# Autodesk Inventor assembly: Assembly
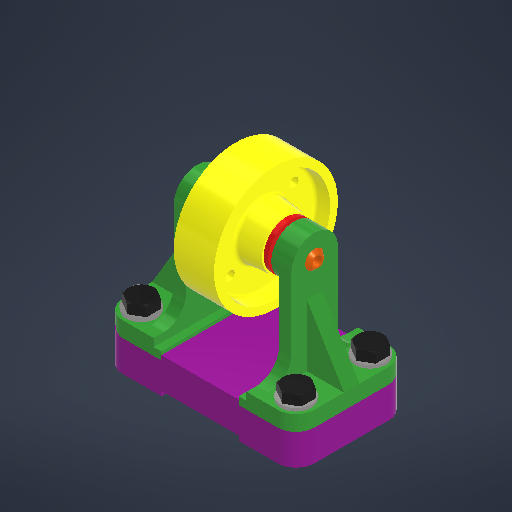
[picture p0: Inventor's stored thumbnail of the model, 512x512]
Saved by Autodesk Inventor 2026.3 (Build 303398000, 398)
## iProperties
Created: 2026-11-02
Part Number: Assembly
Document SubType Name: Assembly
Designer: ADMIN
Author: ADMIN
## Documents named in this file (8)
- E:\study\bách khoa\Vẽ\Bài tập\bản vẽ lắp\Tang Cuốn\Assembly.iam
- E:\study\bách khoa\Vẽ\Bài tập\bản vẽ lắp\Tang Cuốn\Bracket.ipt
- E:\study\bách khoa\Vẽ\Bài tập\bản vẽ lắp\Tang Cuốn\Bushing.ipt
- E:\study\bách khoa\Vẽ\Bài tập\bản vẽ lắp\Tang Cuốn\Roller.ipt
- E:\study\bách khoa\Vẽ\Bài tập\bản vẽ lắp\Tang Cuốn\Shaft.ipt
- E:\study\bách khoa\Vẽ\Bài tập\bản vẽ lắp\Tang Cuốn\Base.ipt
- C:\Users\ADMIN\Documents\Inventor\Content Center Files\R2026\en-US\ISO 4018\ISO 4018 - M10 x 20.ipt
- C:\Users\ADMIN\Documents\Inventor\Content Center Files\R2026\en-US\ISO 7089\ISO 7089 - 10 - 140 HV(1).ipt
## Components (15 placed, 7 different names)
1. Bracket:1 — Mate:1, Mate:2, Mate:3, Mate:11, Mate:12, Mate:14, Mate:15, Mate:16, Mate:17, Mate:18, Mate:28, Mate:30
2. Bushing:1 — Mate:7, Mate:8
3. Roller:1 — Mate:7, Mate:8, Mate:9, Mate:10
4. Shaft:1 — Mate:11, Mate:12, Mate:13
5. Base:1 — Mate:1, Mate:2, Mate:3, Mate:4, Mate:5, Mate:6
6. ISO 4018 M10 x 20:1 — Mate:29, Mate:30
7. ISO 4018 M10 x 20:2 — Mate:25, Mate:26
8. ISO 4018 M10 x 20:3 — Mate:27, Mate:28
9. ISO 4018 M10 x 20:4 — Mate:23, Mate:24
10. Bracket:2 — Mate:4, Mate:5, Mate:6, Mate:19, Mate:20, Mate:21, Mate:22, Mate:24, Mate:26
11. Bushing:2 — Mate:9, Mate:10, Mate:13, Mate:14
12. ISO 7089 10:1 — Mate:15, Mate:16, Mate:27
13. ISO 7089 10:2 — Mate:21, Mate:22, Mate:23
14. ISO 7089 10:3 — Mate:19, Mate:20, Mate:25
15. ISO 7089 10:4 — Mate:17, Mate:18, Mate:29
## Relationships (30: Mate 30)
- Mate:1: Bracket:1 ↔ Base:1
- Mate:2: Bracket:1 ↔ Base:1
- Mate:3: Bracket:1 ↔ Base:1
- Mate:4: Base:1 ↔ Bracket:2
- Mate:5: Base:1 ↔ Bracket:2
- Mate:6: Base:1 ↔ Bracket:2
- Mate:7: Bushing:1 ↔ Roller:1
- Mate:8: Bushing:1 ↔ Roller:1
- Mate:9: Roller:1 ↔ Bushing:2
- Mate:10: Roller:1 ↔ Bushing:2
- Mate:11: Bracket:1 ↔ Shaft:1
- Mate:12: Bracket:1 ↔ Shaft:1
- Mate:13: Shaft:1 ↔ Bushing:2
- Mate:14 (2 mm): Bracket:1 ↔ Bushing:2
- Mate:15: Bracket:1 ↔ ISO 7089 10:1
- Mate:16: Bracket:1 ↔ ISO 7089 10:1
- Mate:17: Bracket:1 ↔ ISO 7089 10:4
- Mate:18: Bracket:1 ↔ ISO 7089 10:4
- Mate:19: Bracket:2 ↔ ISO 7089 10:3
- Mate:20: Bracket:2 ↔ ISO 7089 10:3
- Mate:21: Bracket:2 ↔ ISO 7089 10:2
- Mate:22: Bracket:2 ↔ ISO 7089 10:2
- Mate:23: ISO 4018 M10 x 20:4 ↔ ISO 7089 10:2
- Mate:24: ISO 4018 M10 x 20:4 ↔ Bracket:2
- Mate:25: ISO 4018 M10 x 20:2 ↔ ISO 7089 10:3
- Mate:26: ISO 4018 M10 x 20:2 ↔ Bracket:2
- Mate:27: ISO 4018 M10 x 20:3 ↔ ISO 7089 10:1
- Mate:28: Bracket:1 ↔ ISO 4018 M10 x 20:3
- Mate:29: ISO 4018 M10 x 20:1 ↔ ISO 7089 10:4
- Mate:30: Bracket:1 ↔ ISO 4018 M10 x 20:1
